# Autodesk Inventor assembly: C3v1
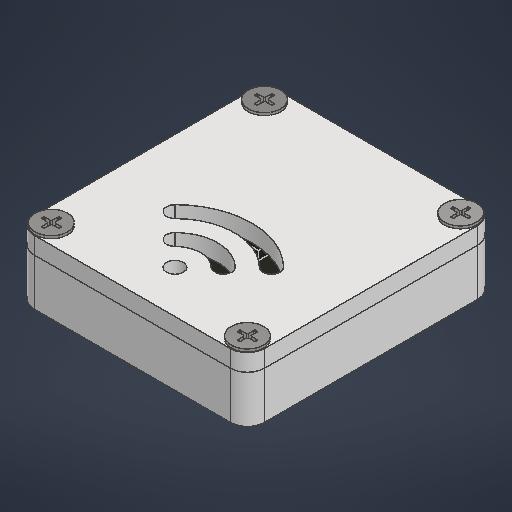
[picture p0: Inventor's stored thumbnail of the model, 512x512]
Saved by Autodesk Inventor 2027.1 (Build 311270010, 270A)
## iProperties
Created: 2026-09-27
Part Number: C3v1
Document SubType Name: Assembly
Designer: work
Author: work
## Documents named in this file (5)
- C:\Users\work\Desktop\Mini WebServer\모델링\C3_v1\C3v1.iam
- C:\Users\work\Desktop\Mini WebServer\모델링\C3_v1\c3 case.ipt
- C:\Users\work\Desktop\Mini WebServer\모델링\C3_v1\c3 cover.ipt
- C:\Users\work\Desktop\Mini WebServer\모델링\C3_v1\esp32-c3-supermini.ipt
- C:\Users\work\Desktop\Mini WebServer\모델링\C3_v1\JIS B 1122 - ST2.2 x 6.5 - C - H(1).ipt
## Components (7 placed, 4 different names)
1. c3 case:1 — 메이트:1, 메이트:2, 메이트:3, 메이트:4, 메이트:5, 메이트:6
2. c3 cover:1 — 메이트:4, 메이트:5, 메이트:6, 삽입:1, 삽입:2, 삽입:3, 삽입:4
3. esp32-c3-supermini:1 — 메이트:1, 메이트:2, 메이트:3
4. JIS B 1122 - ST2.2 x 6.5 - C - H(1):1 — 삽입:1
5. JIS B 1122 - ST2.2 x 6.5 - C - H(1):2 — 삽입:2
6. JIS B 1122 - ST2.2 x 6.5 - C - H(1):3 — 삽입:3
7. JIS B 1122 - ST2.2 x 6.5 - C - H(1):4 — 삽입:4
## Relationships (10: Mate 6, Insert 4)
- 메이트:1 [Mate]: c3 case:1 ↔ esp32-c3-supermini:1
- 메이트:2 [Mate]: c3 case:1 ↔ esp32-c3-supermini:1
- 메이트:3 [Mate] (0.5 mm): c3 case:1 ↔ esp32-c3-supermini:1
- 메이트:4 [Mate]: c3 case:1 ↔ c3 cover:1
- 메이트:5 [Mate]: c3 case:1 ↔ c3 cover:1
- 메이트:6 [Mate]: c3 case:1 ↔ c3 cover:1
- 삽입:1 [Insert]: c3 cover:1 ↔ JIS B 1122 - ST2.2 x 6.5 - C - H(1):1
- 삽입:2 [Insert]: c3 cover:1 ↔ JIS B 1122 - ST2.2 x 6.5 - C - H(1):2
- 삽입:3 [Insert]: c3 cover:1 ↔ JIS B 1122 - ST2.2 x 6.5 - C - H(1):3
- 삽입:4 [Insert]: c3 cover:1 ↔ JIS B 1122 - ST2.2 x 6.5 - C - H(1):4
